# Autodesk Inventor assembly: Sujeta_Cables_Completo
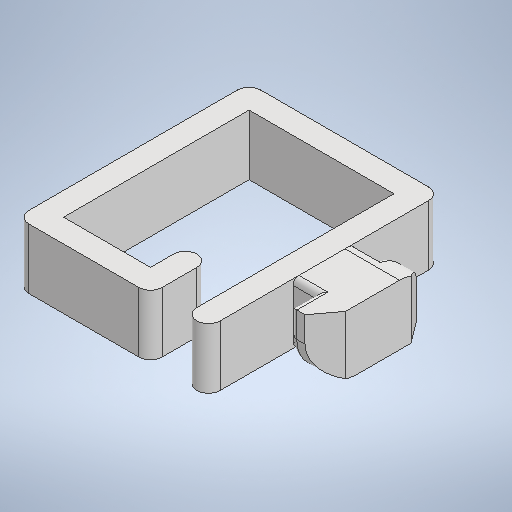
[picture p0: Inventor's stored thumbnail of the model, 512x512]
Saved by Autodesk Inventor 2025.3 (Build 293356030, 356C)
## iProperties
Created: 2026-05-06
Part Number: Sujeta_Cables_Completo
Document SubType Name: Assembly
Designer: pablo
Author: pablo
## Documents named in this file (3)
- C:\Users\pablo\OneDrive - Universidad del Valle de Guatemala\Documentos\9 Semestre\Tesis\INVENTOR_TESIS\Sujeta_Cables_Completo.iam
- C:\Users\pablo\OneDrive - Universidad del Valle de Guatemala\Documentos\9 Semestre\Tesis\INVENTOR_TESIS\Sujeta_Cables.ipt
- C:\Users\pablo\OneDrive - Universidad del Valle de Guatemala\Documentos\9 Semestre\Tesis\INVENTOR_TESIS\Agarrador_20x20.ipt
## Components (2 placed, 2 different names)
1. Sujeta_Cables:1 — Flush:1, Mate:1, Flush:2
2. Agarrador_20x20:1 — Flush:1, Mate:1, Flush:2
## Relationships (3: Flush 2, Mate 1)
- Flush:1: Sujeta_Cables:1 ↔ Agarrador_20x20:1
- Mate:1: Sujeta_Cables:1 ↔ Agarrador_20x20:1
- Flush:2 (7.4 mm): Sujeta_Cables:1 ↔ Agarrador_20x20:1
